# Autodesk Inventor assembly: 部件1
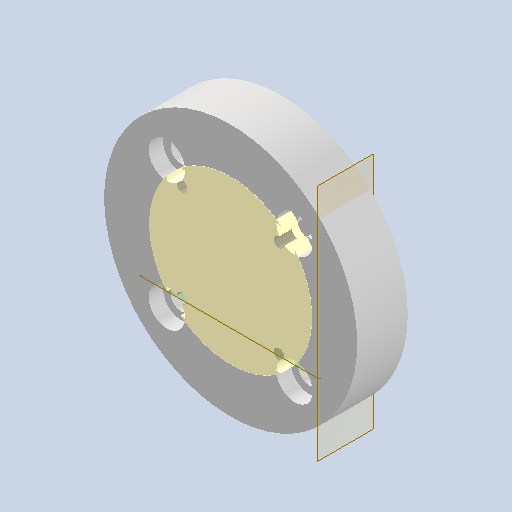
[picture p0: Inventor's stored thumbnail of the model, 512x512]
Saved by Autodesk Inventor 2025 (Build 290162000, 162)
## iProperties
Created: 2026-11-03
Part Number: 部件1
Document SubType Name: Assembly
Designer: test
Author: test
## Documents named in this file (3)
- D:\Desktop\新建文件夹\部件1.iam
- D:\Desktop\新建文件夹\零件1.ipt
- D:\Desktop\新建文件夹\零件2.ipt
## Components (2 placed, 2 different names)
1. 零件1:1 — 配合:1, 配合:2
2. 零件2:1 — 配合:1, 配合:2
## Relationships (2: Mate 2)
- 配合:1 [Mate]: 零件1:1 ↔ 零件2:1
- 配合:2 [Mate]: 零件1:1 ↔ 零件2:1
